# Autodesk Inventor assembly: Deska spoje
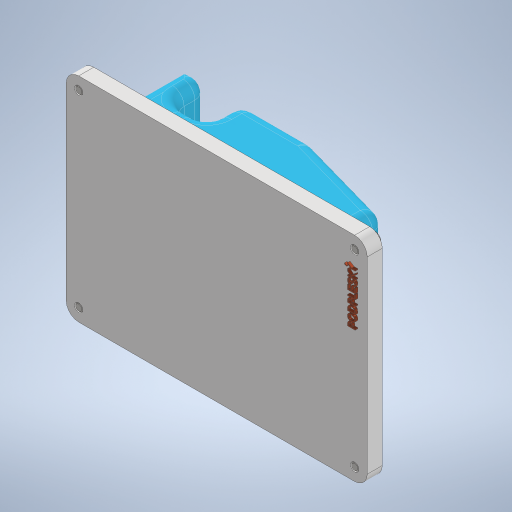
[picture p0: Inventor's stored thumbnail of the model, 512x512]
Saved by Autodesk Inventor 2024 (Build 280153000, 153)
## iProperties
Created: 2025-09-30
Part Number: Deska spoje
Document SubType Name: Assembly
Designer: zak
Author: zak
## Documents named in this file (4)
- D:\NEVIM\Deska spoje.iam
- D:\NEVIM\Deska spoje.ipt
- D:\NEVIM\Obal součástí.ipt
- D:\NEVIM\CSN 02 1131 - M3 x 6A.ipt
## Components (6 placed, 3 different names)
1. Deska spoje:1 — Proti sobě:1, Proti sobě:2, Proti sobě:3, Proti sobě:4, Proti sobě:5, Stejný směr:1, Vložit:1, Vložit:2, Vložit:3, Vložit:4
2. Obal součástí:1 — Proti sobě:1, Proti sobě:2, Proti sobě:3
3. CSN 02 1131 - M3 x 6A:1 — Vložit:2
4. CSN 02 1131 - M3 x 6A:2 — Vložit:1
5. CSN 02 1131 - M3 x 6A:3 — Vložit:3
6. CSN 02 1131 - M3 x 6A:4 — Vložit:4
## Relationships (10: Mate 5, Insert 4, Flush 1)
- Proti sobě:1 [Mate]: Deska spoje:1 ↔ Obal součástí:1
- Proti sobě:2 [Mate]: Deska spoje:1 ↔ Obal součástí:1
- Proti sobě:3 [Mate]: Deska spoje:1 ↔ Obal součástí:1
- Proti sobě:4 [Mate]: Deska spoje:1
- Proti sobě:5 [Mate]: Deska spoje:1
- Stejný směr:1 [Flush]: Deska spoje:1
- Vložit:1 [Insert]: Deska spoje:1 ↔ CSN 02 1131 - M3 x 6A:2
- Vložit:2 [Insert]: Deska spoje:1 ↔ CSN 02 1131 - M3 x 6A:1
- Vložit:3 [Insert]: Deska spoje:1 ↔ CSN 02 1131 - M3 x 6A:3
- Vložit:4 [Insert]: Deska spoje:1 ↔ CSN 02 1131 - M3 x 6A:4
